# Autodesk Inventor assembly: Transmisión por cadena
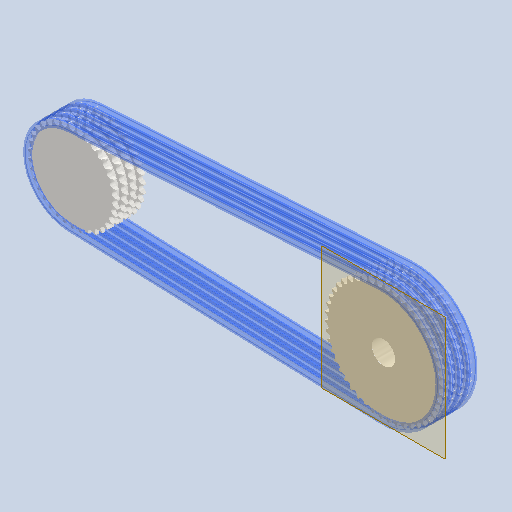
[picture p0: Inventor's stored thumbnail of the model, 512x512]
Saved by Autodesk Inventor 2024 (Build 280153000, 153)
## iProperties
ClientObjectVersion: 1
Created: 2024-09-19
Part Number: Transmisión por cadena
Document SubType Name: Assembly
Designer: aulac205
Author: aulac205
## Documents named in this file (4)
- C:\Users\aulac205\Documents\Inventor\Cadena\Design Accelerator\Transmisión por cadena1.iam
- C:\Users\aulac205\Documents\Inventor\Cadena\Design Accelerator\Cadena de rodillos1.ipt
- C:\Users\aulac205\Documents\Inventor\Cadena\Design Accelerator\Rueda dentada de cadena de rodillos11.ipt
- C:\Users\aulac205\Documents\Inventor\Cadena\Design Accelerator\Rueda dentada de cadena de rodillos21.ipt
## Components (3 placed, 3 different names)
1. Cadena de rodillos:1 — Nivelación:4, Coincidencia:1, Coincidencia:2, Nivelación:5, Coincidencia:3, Coincidencia:4
2. Rueda dentada de cadena de rodillos1:1 — Nivelación:3, Nivelación:4, Coincidencia:1, Coincidencia:2, Rotación:1
3. Rueda dentada de cadena de rodillos2:1 — Nivelación:3, Nivelación:5, Coincidencia:3, Rotación:1, Coincidencia:4
## Relationships (8: Mate 4, Flush 3, RelateRotation 1)
- Nivelación:3 [Flush]: Rueda dentada de cadena de rodillos1:1 ↔ Rueda dentada de cadena de rodillos2:1
- Nivelación:4 [Flush]: Cadena de rodillos:1 ↔ Rueda dentada de cadena de rodillos1:1
- Coincidencia:1 [Mate]: Cadena de rodillos:1 ↔ Rueda dentada de cadena de rodillos1:1
- Coincidencia:2 [Mate]: Cadena de rodillos:1 ↔ Rueda dentada de cadena de rodillos1:1
- Nivelación:5 [Flush]: Cadena de rodillos:1 ↔ Rueda dentada de cadena de rodillos2:1
- Coincidencia:3 [Mate]: Cadena de rodillos:1 ↔ Rueda dentada de cadena de rodillos2:1
- Rotación:1 [RelateRotation] (1.3429 ul): Rueda dentada de cadena de rodillos1:1 ↔ Rueda dentada de cadena de rodillos2:1
- Coincidencia:4 [Mate]: Cadena de rodillos:1 ↔ Rueda dentada de cadena de rodillos2:1
